# Autodesk Inventor assembly: 25-02-23-mect356-747-jumbo-jet-Lawrenc-Abou-karroum
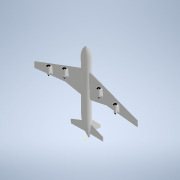
[picture p0: Inventor's stored thumbnail of the model, 180x180]
Saved by Autodesk Inventor 2022 (Build 260153000, 153)
## iProperties
Created: 2025-02-23
Part Number: 25-02-23-mect356-747-jumbo-jet-Lawrenc-Abou-karroum
Document SubType Name: Assembly
Designer: Dell
Author: Dell
## Documents named in this file (4)
- C:\Users\Dell\Desktop\Uni New\aircraft\25-02-23-mect356-747-jumbo-jet-Lawrenc-Abou-karroum.iam
- C:\Users\Dell\Desktop\Uni New\aircraft\motor.ipt
- C:\Users\Dell\Desktop\Uni New\aircraft\plane.ipt
- C:\Users\Dell\Desktop\Uni New\aircraft\motor_MIR2.ipt
## Components (5 placed, 3 different names)
1. plane:1 — Mate:1, Flush:1, Mate:2
2. motor_MIR2:1
3. motor_MIR2:2
4. motor:1 — Mate:1, Flush:1, Mate:2
5. motor:2
## Component patterns: (2 elements, first: motor:1)
## Relationships (3: Mate 2, Flush 1)
- Mate:1: plane:1 ↔ motor:1
- Flush:1 (-140 mm): plane:1 ↔ motor:1
- Mate:2 (-200 mm): plane:1 ↔ motor:1
